# Autodesk Inventor assembly: MM0948AN170_G13_001
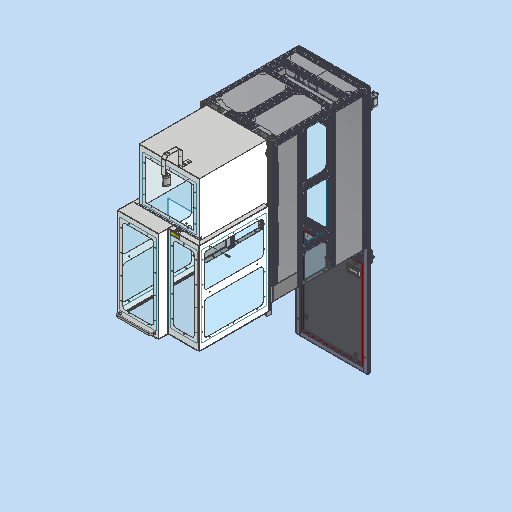
[picture p0: Inventor's stored thumbnail of the model, 512x512]
Saved by Autodesk Inventor 2023.3 (Build 273359000, 359)
## iProperties
Created: 2023-03-23
Part Number: MM0948AN170_G13_001
Description: =<RBPARTNOTITLE2>
Document SubType Name: Assembly
Designer: FH/Wi
Mass: 139010 g
Surface Area: 406545 cm^2
Volume: 49256.3 cm^3
Density: 2.82217 g/cm^3
AnP_Kategorie: 99
AnP_Material: =<Material>
MaxAbmaße: 935,396 x 1845,895 x 2697,284 (FM)
AnP_TemplVers: 20200821
RBDOCUMENTTYPE: DRF
RBDOCUMENTVERSION: 00
RBDRAWINGMAINSCALE: 1:1
RBDRAWINGMISSINGSPEC: --
RBDRAWINGVOLUME: --
RBDSV1: 0850
RBGBEDGESIN1: +0,5
RBGBEDGESIN2: +0,2
RBGBEDGESOUT1: -0,3
RBGBEDGESOUT2: -0,1
RBMATERIAL: =<Material>
RBMATMEETS: --
RBMATNO: =<Part Number>
RBPARTNO: SIEHE MNR
RBPARTNOTITLE1: Cluster Safety cover CIPG 1840 singel
RBPARTNOTITLE2: Cluster Schutzhaube CIPG 1840 einfach
RBPARTSAFETYINDICATOR: --
RBSURFACE: --
RBSURFACE2: --
RBZEDGESNORM: ISO13715:2002-06
RBZGENDIMCLASS: m
RBZGENDIMNORM: ISO 2768-1:1989-11
RBZGENGEOCLASS: H
RBZGENGEONORM: ISO 2768-2:1989-11
RBZSURFACENORM: ISO13D2:2002-02
RBZTOLERANCENORM: ISO 14405-1:2010-12
Author: FH/Wi
Keywords: =<RBPARTMADEOF>
Comments: =<RBSURFACE2>
Revision Number: 01
## Documents named in this file (15)
- C:\Users\rea9an\Documents\Inventor\TCAI2412_te1910_EM\AS00000969.iam
- C:\Users\rea9an\Documents\Inventor\TCAI2412_te1910_EM\AS00000915.iam
- C:\Users\rea9an\Documents\Inventor\TCAI2412_te1910_EM\AS00000916.iam
- C:\Users\rea9an\Documents\Inventor\TCAI2412_te1910_EM\AS00000917.iam
- C:\Users\rea9an\Documents\Inventor\TCAI2412_te1910_EM\AS00000918.iam
- C:\Users\rea9an\Documents\Inventor\TCAI2412_te1910_EM\PT00004465.ipt
- C:\Users\rea9an\Documents\Inventor\TCAI2412_te1910_EM\AS00000964.iam
- C:\Users\rea9an\Documents\Inventor\TCAI2412_te1910_EM\AS00000965.iam
- C:\Users\rea9an\Documents\Inventor\TCAI2412_te1910_EM\AS00000966.iam
- C:\Users\rea9an\Documents\Inventor\TCAI2412_te1910_EM\AS00000963.iam
- C:\Users\rea9an\Documents\Inventor\TCAI2412_te1910_EM\AS00000962.iam
- C:\Users\rea9an\Documents\Inventor\TCAI2412_te1910_EM\AS00000919.iam
- C:\Users\rea9an\Documents\Inventor\TCAI2412_te1910_EM\AS00000967.iam
- C:\Users\rea9an\Documents\Inventor\TCAI2412_te1910_EM\AS00000968.iam
- C:\Users\rea9an\Documents\Inventor\TCAI2412_te1910_EM\AS00000923.iam
## Components (15 placed, 14 different names)
1. PT00004465:1
2. AS00000915:4 [sub-assembly] — Einfügen:28, Einfügen:29
3. AS00000916:1 [sub-assembly] — Einfügen:24, Passend:19
4. AS00000916:2 [sub-assembly] — Einfügen:23, Passend:18
5. AS00000917:1 [sub-assembly] — Einfügen:25, Passend:20
6. AS00000918:1 [sub-assembly]
7. AS00000923:1 [sub-assembly] — Einfügen:35, Passend:25
8. AS00000967:1 [sub-assembly] — Fluchtend:50, Fluchtend:51, Passend:23, Einfügen:26, Einfügen:27, Einfügen:28, Einfügen:29, Einfügen:30, Einfügen:32, Einfügen:33, Einfügen:34, Passend:24
9. AS00000962:1 [sub-assembly] — Fluchtend:14, Fluchtend:15, Passend:5, Einfügen:23, Einfügen:24, Einfügen:25, Passend:18, Passend:19, Passend:20, Fluchtend:50, Fluchtend:51, Passend:23
10. AS00000963:1 [sub-assembly] — Fluchtend:55, Fluchtend:56, Fluchtend:57
11. AS00000968:1 [sub-assembly] — Fluchtend:19, Fluchtend:20, Fluchtend:21, Passend:24, Einfügen:35, Passend:25
12. AS00000964:1 [sub-assembly] — Einfügen:30, Einfügen:33
13. AS00000965:1 [sub-assembly] — Einfügen:32, Einfügen:34
14. AS00000966:1 [sub-assembly] — Einfügen:26, Einfügen:27
15. AS00000919:1 [sub-assembly] — Fluchtend:53, Fluchtend:52, Fluchtend:54
## Relationships (38: Flush 17, Insert 12, Mate 9)
- Fluchtend:14 [Flush]: AS00000962:1
- Fluchtend:15 [Flush]: AS00000962:1
- Passend:5 [Mate] (1248 mm): AS00000962:1
- Fluchtend:19 [Flush]: AS00000968:1
- Fluchtend:20 [Flush]: AS00000968:1
- Fluchtend:21 [Flush]: AS00000968:1
- [Flush]: AS00000918:1 ↔ AS00000962:1
- [Flush] (-25 mm): AS00000918:1 ↔ AS00000962:1
- [Mate] (-190.5 mm): AS00000918:1 ↔ AS00000962:1
- Einfügen:23 [Insert]: AS00000916:2 ↔ AS00000962:1
- Einfügen:24 [Insert]: AS00000916:1 ↔ AS00000962:1
- Einfügen:25 [Insert]: AS00000917:1 ↔ AS00000962:1
- Passend:18 [Mate]: AS00000916:2 ↔ AS00000962:1
- Passend:19 [Mate]: AS00000916:1 ↔ AS00000962:1
- Passend:20 [Mate]: AS00000917:1 ↔ AS00000962:1
- [Mate] (2 mm): PT00004465:1 ↔ AS00000918:1
- [Flush] (7 mm): PT00004465:1 ↔ AS00000918:1
- [Flush] (-8 mm): PT00004465:1 ↔ AS00000918:1
- Fluchtend:50 [Flush]: AS00000967:1 ↔ AS00000962:1
- Fluchtend:51 [Flush] (-2.5 mm): AS00000967:1 ↔ AS00000962:1
- Passend:23 [Mate]: AS00000967:1 ↔ AS00000962:1
- Einfügen:26 [Insert]: AS00000967:1 ↔ AS00000966:1
- Einfügen:27 [Insert]: AS00000967:1 ↔ AS00000966:1
- Einfügen:28 [Insert]: AS00000915:4 ↔ AS00000967:1
- Einfügen:29 [Insert]: AS00000915:4 ↔ AS00000967:1
- Einfügen:30 [Insert]: AS00000967:1 ↔ AS00000964:1
- Einfügen:32 [Insert]: AS00000967:1 ↔ AS00000965:1
- Einfügen:33 [Insert]: AS00000967:1 ↔ AS00000964:1
- Einfügen:34 [Insert]: AS00000967:1 ↔ AS00000965:1
- Passend:24 [Mate]: AS00000967:1 ↔ AS00000968:1
- Fluchtend:53 [Flush]: AS00000919:1
- Fluchtend:52 [Flush]: AS00000919:1
- Fluchtend:54 [Flush]: AS00000919:1
- Fluchtend:55 [Flush]: AS00000963:1
- Fluchtend:56 [Flush]: AS00000963:1
- Fluchtend:57 [Flush]: AS00000963:1
- Einfügen:35 [Insert]: AS00000923:1 ↔ AS00000968:1
- Passend:25 [Mate]: AS00000923:1 ↔ AS00000968:1
